# Autodesk Inventor assembly: Chassis
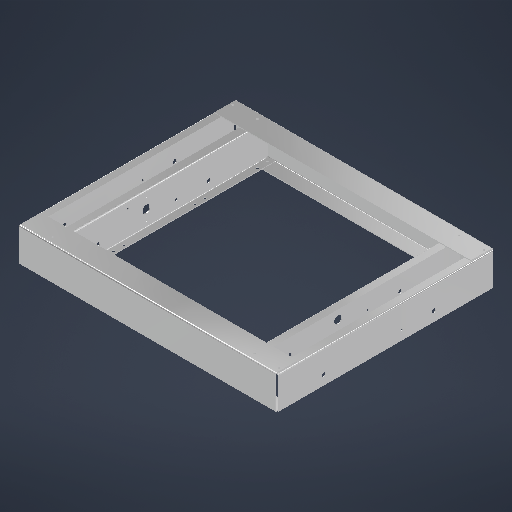
[picture p0: Inventor's stored thumbnail of the model, 512x512]
Saved by Autodesk Inventor 2026.2 (Build 302298010, 298A)
## iProperties
Created: 2026-10-11
Part Number: Chassis
Document SubType Name: Assembly
Designer: User
Author: User
## Documents named in this file (6)
- D:\Autodesk Invento Pro Work\Honours Project\Parts\Chassis.iam
- D:\Autodesk Invento Pro Work\Honours Project\Parts\C_Bend.ipt
- D:\Autodesk Invento Pro Work\Honours Project\Parts\L_Bend.ipt
- D:\Autodesk Invento Pro Work\Honours Project\Parts\S_Bend.ipt
- D:\Autodesk Invento Pro Work\Honours Project\Parts\S_Bend_MIR1.ipt
- D:\Autodesk Invento Pro Work\Honours Project\Parts\L_Bend_MIR.ipt
## Components (6 placed, 5 different names)
1. C_Bend:1 — Mate:5
2. C_Bend:2 — Mate:1, Mate:2, Mate:3, Mate:4
3. L_Bend:1 — Mate:2
4. S_Bend:1 — Mate:1, Mate:5
5. S_Bend_MIR1:1 — Mate:3
6. L_Bend_MIR:1 — Mate:4
## Relationships (5: Mate 5)
- Mate:1: C_Bend:2 ↔ S_Bend:1
- Mate:2: C_Bend:2 ↔ L_Bend:1
- Mate:3: C_Bend:2 ↔ S_Bend_MIR1:1
- Mate:4: C_Bend:2 ↔ L_Bend_MIR:1
- Mate:5: C_Bend:1 ↔ S_Bend:1
